# Autodesk Inventor assembly: MM0937AN200_G04_826
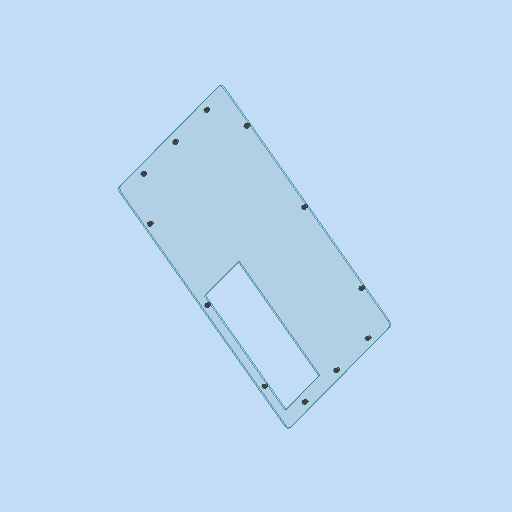
[picture p0: Inventor's stored thumbnail of the model, 512x512]
Saved by Autodesk Inventor 2023.3 (Build 273359000, 359)
## iProperties
RuleStatus: InUse
Created: 2021-07-13
Part Number: MM0937AN200_G04_826
Description: =<RBPARTNOTITLE2>
Document SubType Name: Assembly
Designer: frt9bw
Mass: 787.226 g
Surface Area: 4407.85 cm^2
Volume: 642.752 cm^3
Density: 1.22478 g/cm^3
AnP_Material: =<Material>
AnP_TemplVers: 20200821
RBDOCUMENTTYPE: DRF
RBDOCUMENTVERSION: 00
RBDRAWINGMAINSCALE: 1:1
RBDRAWINGMISSINGSPEC: --
RBDRAWINGVOLUME: --
RBDSV1: 0850
RBGBEDGESIN1: +0,5
RBGBEDGESIN2: +0,2
RBGBEDGESOUT1: -0,3
RBGBEDGESOUT2: -0,1
RBMATERIAL: =<Material>
RBMATMEETS: --
RBMATNO: =<Part Number>
RBPARTMADEOF: --
RBPARTNO: SIEHE MNR
RBPARTNOTITLE1: --
RBPARTSAFETYINDICATOR: --
RBSURFACE: --
RBSURFACE2: --
RBZEDGESNORM: ISO13715:2002-06
RBZGENDIMCLASS: m
RBZGENDIMNORM: ISO 2768-1:1989-11
RBZGENGEOCLASS: H
RBZGENGEONORM: ISO 2768-2:1989-11
RBZSURFACENORM: ISO13D2:2002-02
RBZTOLERANCENORM: ISO 14405-1:2010-12
Author: frt9bw
Keywords: =<RBPARTMADEOF>
Comments: =<RBSURFACE2>
Revision Number: 01
## Documents named in this file (4)
- C:\Users\rea9an\Documents\Inventor\TCAI2412_te1910_EM\AS00000923.iam
- C:\Users\rea9an\Documents\Inventor\TCAI2412_te1910_EM\PT00004822.ipt
- C:\Users\rea9an\Documents\Inventor\TCAI2412_te1910_EM\PT00004778.ipt
- C:\Users\rea9an\Documents\Inventor\TCAI2412_te1910_EM\PT00004567.ipt
## Components (25 placed, 3 different names)
1. PT00004567:1 — Einfügen:11, Einfügen:12, Einfügen:13, Einfügen:14, Einfügen:15, Einfügen:16, Einfügen:17, Einfügen:18, Einfügen:19, Einfügen:20, Einfügen:23, Einfügen:24
2. PT00004822:1
3. PT00004778:1 — Einfügen:11
4. PT00004822:2
5. PT00004778:2 — Einfügen:12
6. PT00004822:3
7. PT00004778:3 — Einfügen:13
8. PT00004822:4
9. PT00004778:4 — Einfügen:14
10. PT00004822:5
11. PT00004778:5 — Einfügen:15
12. PT00004822:6
13. PT00004778:6 — Einfügen:16
14. PT00004822:7
15. PT00004778:7 — Einfügen:17
16. PT00004822:8
17. PT00004778:8 — Einfügen:18
18. PT00004822:9
19. PT00004778:9 — Einfügen:19
20. PT00004822:10
21. PT00004778:10 — Einfügen:20
22. PT00004822:11
23. PT00004778:11 — Einfügen:23
24. PT00004822:12
25. PT00004778:12 — Einfügen:24
## Relationships (24: Insert 24)
- [Insert]: PT00004822:1 ↔ PT00004778:1
- [Insert]: PT00004822:2 ↔ PT00004778:2
- [Insert]: PT00004822:3 ↔ PT00004778:3
- [Insert]: PT00004822:4 ↔ PT00004778:4
- [Insert]: PT00004822:5 ↔ PT00004778:5
- [Insert]: PT00004822:6 ↔ PT00004778:6
- [Insert]: PT00004822:7 ↔ PT00004778:7
- [Insert]: PT00004822:8 ↔ PT00004778:8
- [Insert]: PT00004822:9 ↔ PT00004778:9
- [Insert]: PT00004822:10 ↔ PT00004778:10
- Einfügen:11 [Insert]: PT00004567:1 ↔ PT00004778:1
- Einfügen:12 [Insert]: PT00004567:1 ↔ PT00004778:2
- Einfügen:13 [Insert]: PT00004567:1 ↔ PT00004778:3
- Einfügen:14 [Insert]: PT00004567:1 ↔ PT00004778:4
- Einfügen:15 [Insert]: PT00004567:1 ↔ PT00004778:5
- Einfügen:16 [Insert]: PT00004567:1 ↔ PT00004778:6
- Einfügen:17 [Insert]: PT00004567:1 ↔ PT00004778:7
- Einfügen:18 [Insert]: PT00004567:1 ↔ PT00004778:8
- Einfügen:19 [Insert]: PT00004567:1 ↔ PT00004778:9
- Einfügen:20 [Insert]: PT00004567:1 ↔ PT00004778:10
- [Insert]: PT00004822:11 ↔ PT00004778:11
- [Insert]: PT00004822:12 ↔ PT00004778:12
- Einfügen:23 [Insert]: PT00004567:1 ↔ PT00004778:11
- Einfügen:24 [Insert]: PT00004567:1 ↔ PT00004778:12
## Named parameters: d4_d15_d809_d804 = 0 mm, d1_d4_d15_d809_d804 = 0 mm, d2_d4_d15_d809_d804 = 0 mm, d3_d4_d15_d809_d804 = 0 mm, d4_d4_d15_d809_d804 = 0 mm, d5_d4_d15_d809_d804 = 0 mm, d6_d4_d15_d809_d804 = 0 mm, d7_d4_d15_d809_d804 = 0 mm, d8_d4_d15_d809_d804 = 0 mm, d9_d4_d15_d809_d804 = 0 mm, d20_d1_d4_d15_d809_d804 = 0 mm, d21_d1_d4_d15_d809_d804 = 0 mm
